# Autodesk Inventor assembly: Exploded View Z-Axis
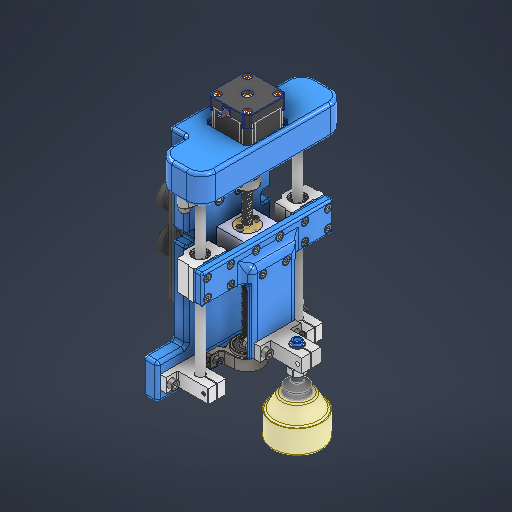
[picture p0: Inventor's stored thumbnail of the model, 512x512]
Saved by Autodesk Inventor 2027.1 (Build 311270010, 270A)
## iProperties
Created: 2026-10-04
Part Number: Exploded View Z-Axis
Document SubType Name: Assembly
Designer: Ahmed
Author: Ahmed
## iProperties of the stored document nippel.ipt
Created: 2014-03-17
Part Number: nippel
Material: Generic
Document SubType Name: Modeling
Designer: Ahmed
Density: 1 g/cm^3
Appearance: Default
Mass: 1.51643 g
Surface Area: 12.4065 cm^2
Volume: 1.51643 cm^3
Sending System: SOLIDWORKS 2012
Last Saved Date: 2014-05-13
last saved by: Oleg
Author: Ahmed
## iProperties of the stored document IPCF06-02.iam
Company: Open CASCADE
Created: 2026-10-23
Part Number: IPCF06-02
Description: Open CASCADE Model
Document SubType Name: Assembly
Designer: Ahmed
Authority: Unknown
Mass: 1.21454 g
Surface Area: 16.1477 cm^2
Volume: 1.21454 cm^3
Density: 1 g/cm^3
Sending System: Open CASCADE 7.9
Preprocessor: Open CASCADE STEP processor 7.9
Title: Open CASCADE Shape Model
Author: Author
## iProperties of the stored document Suction-ohne-nippel.ipt
Created: 2014-03-17
Part Number: Suction-ohne-nippel
Material: Generic
Document SubType Name: Modeling
Designer: Ahmed
Density: 1 g/cm^3
Appearance: Default
Mass: 1.14453 g
Surface Area: 25.0648 cm^2
Volume: 1.14453 cm^3
Sending System: SOLIDWORKS 2012
Last Saved Date: 2014-05-13
last saved by: Oleg
Author: Ahmed
## iProperties of the stored document release_ring.ipt
Created: 2026-10-23
Part Number: release_ring
Material: Generic
Document SubType Name: Modeling
Designer: Ahmed
Density: 1 g/cm^3
Appearance: Default
Mass: 0.104785 g
Surface Area: 2.06972 cm^2
Volume: 0.104785 cm^3
Author: Ahmed
## iProperties of the stored document Suction.iam
Created: 2014-03-17
Part Number: Suction
Document SubType Name: Assembly
Designer: Ahmed
Mass: 2.66095 g
Surface Area: 37.4713 cm^2
Volume: 2.66095 cm^3
Density: 1 g/cm^3
Sending System: SOLIDWORKS 2012
last saved by: Oleg
Last Saved Date: 2014-05-13
Author: Ahmed
## iProperties of the stored document body.ipt
Created: 2026-10-23
Part Number: body
Material: Generic
Document SubType Name: Modeling
Designer: Ahmed
Density: 1 g/cm^3
Appearance: Default
Mass: 1.10976 g
Surface Area: 14.0779 cm^2
Volume: 1.10976 cm^3
Author: Ahmed
## Documents named in this file (45)
- C:\Users\Ahmed\Desktop\Fall 26\MCT333 Design of Mechatronics Systems 1\Project\CAD\Exploded View Z-Axis.iam
- C:\Users\Ahmed\Desktop\Fall 26\MCT333 Design of Mechatronics Systems 1\Project\CAD\AluminumExtrusion\AluminumExtrusion\AluminiumExtrusion2020\2020extrusion_ipt\2020aluminum_extrusion_black.ipt
- C:\Users\Ahmed\Desktop\Fall 26\MCT333 Design of Mechatronics Systems 1\Project\CAD\V-Pulley.ipt
- C:\Users\Ahmed\Desktop\Fall 26\MCT333 Design of Mechatronics Systems 1\Project\CAD\VSoltGantrySetAllSizes\VSoltGantrySetAllSizes\40mm Gantry Set universal\127x88 Gantry.ipt
- C:\Users\Ahmed\Desktop\Fall 26\MCT333 Design of Mechatronics Systems 1\Project\CAD\sk8-linear-shaft-support-8mm-1.snapshot.1\SK8 Linear Shaft Support, 8mm v4\SK8 Linear Shaft Support, 8mm v4.ipt
- C:\Users\Ahmed\Desktop\Fall 26\MCT333 Design of Mechatronics Systems 1\Project\CAD\scs8uu-linear-bearing-block-8mm-shaft-1.snapshot.1\SCS8UU Block, Linear Bearing, 8mm Shaft v4\SCS8UU Block, Linear Bearing, 8mm.ipt
- C:\Users\Ahmed\Desktop\Fall 26\MCT333 Design of Mechatronics Systems 1\Project\CAD\shf10-shf8-linear-shaft-support-1.snapshot.6\SHF8\SHF8.ipt
- C:\Users\Ahmed\Desktop\Fall 26\MCT333 Design of Mechatronics Systems 1\Project\CAD\KP08 Pillow block bearing 08mm diameter\KP08 Pillow block bearing 08mm diameter.ipt
- C:\Users\Ahmed\Desktop\Fall 26\MCT333 Design of Mechatronics Systems 1\Project\CAD\nema-17-40mm-stepper-motor-1.snapshot.22\17HM15-0904S\17HM15-0904S\17HM15-0904S.ipt
- C:\Users\Ahmed\Desktop\Fall 26\MCT333 Design of Mechatronics Systems 1\Project\CAD\aluminum-flexible-shaft-coupling-5mm-x-8mm-1.snapshot.1\Flexible Shaft Coupling 5mm to 8mm\Flexible_Shaft_Coupling_5_to_8mm v7.ipt
- C:\Users\Ahmed\Desktop\Fall 26\MCT333 Design of Mechatronics Systems 1\Project\CAD\Z Bracket.ipt
- C:\Users\Ahmed\Desktop\Fall 26\MCT333 Design of Mechatronics Systems 1\Project\CAD\tr8x8-4-8mm-4-start-lead-screw-1.snapshot.6\Trapezoidal lead screw tr8x8-4\Trapezoidal lead screw tr8x8-4.ipt
- C:\Users\Ahmed\Desktop\Fall 26\MCT333 Design of Mechatronics Systems 1\Project\CAD\t8_nut_housing\t8_nut_housing.ipt
- C:\Users\Ahmed\Desktop\Fall 26\MCT333 Design of Mechatronics Systems 1\Project\CAD\shf10-shf8-linear-shaft-support-1.snapshot.6\SHF8\SHF8_MIR.ipt
- C:\Users\Ahmed\Desktop\Fall 26\MCT333 Design of Mechatronics Systems 1\Project\CAD\Linear Guide Rods.ipt
- C:\Users\Ahmed\Documents\Inventor\Content Center Files\R2027\en-US\ISO 4032(2)\ISO 4032 - M5 - ISO.ipt
- C:\Users\Ahmed\Documents\Inventor\Content Center Files\R2027\en-US\ISO 4762(2)\ISO 4762 - M5 x 16ISO.ipt
- C:\Users\Ahmed\Desktop\Fall 26\MCT333 Design of Mechatronics Systems 1\Project\CAD\Bearing Spacer.ipt
- C:\Users\Ahmed\Desktop\Fall 26\MCT333 Design of Mechatronics Systems 1\Project\CAD\Insert M5 D7 L9.5mm\Insert M5 D7 L9.5mm.ipt
- C:\Users\Ahmed\Desktop\Fall 26\MCT333 Design of Mechatronics Systems 1\Project\CAD\M4 Insert\M4 Insert.ipt
- C:\Users\Ahmed\Documents\Inventor\Content Center Files\R2027\en-US\ISO 4762(2)\ISO 4762 - M5 x 20ISO.ipt
- C:\Users\Ahmed\Documents\Inventor\Content Center Files\R2027\en-US\ISO 4762(2)\ISO 4762 - M4 x 16ISO.ipt
- C:\Users\Ahmed\Documents\Inventor\Content Center Files\R2027\en-US\ISO 4762(2)\ISO 4762 - M3 x 16ISO.ipt
- C:\Users\Ahmed\Desktop\Fall 26\MCT333 Design of Mechatronics Systems 1\Project\CAD\Linear Bearing Spacer.ipt
- C:\Users\Ahmed\Desktop\Fall 26\MCT333 Design of Mechatronics Systems 1\Project\CAD\T8 nut\T8 nut.ipt
- C:\Users\Ahmed\Documents\Inventor\Content Center Files\R2027\en-US\ISO 4762(2)\ISO 4762 - M3 x 12ISO.ipt
- C:\Users\Ahmed\Desktop\Fall 26\MCT333 Design of Mechatronics Systems 1\Project\CAD\NO-NC Bump Switch\NO-NC Bump Switch.ipt
- C:\Users\Ahmed\Desktop\Fall 26\MCT333 Design of Mechatronics Systems 1\Project\CAD\Limit Switch Spacer.ipt
- C:\Users\Ahmed\Desktop\Fall 26\MCT333 Design of Mechatronics Systems 1\Project\CAD\SK12 SHAFT HOLDER\SK12 SHAFT HOLDER.ipt
- C:\Users\Ahmed\Desktop\Fall 26\MCT333 Design of Mechatronics Systems 1\Project\CAD\Suction Cup Fixation.ipt
- **C:\Users\Ahmed\Desktop\Fall 26\MCT333 Design of Mechatronics Systems 1\Project\CAD\Exploded View Z-Axis.iam*LocalDocs*xAaaaqrcaAaaaaaaaAaaaavx32f*Suction.iam
- C:\Users\Ahmed\Documents\Inventor\Content Center Files\R2027\en-US\ISO 4762(2)\ISO 4762 - M4 x 12ISO.ipt
- C:\Users\Ahmed\Documents\Inventor\Content Center Files\R2027\en-US\ISO 4762(2)\ISO 4762 - M4 x 8ISO.ipt
- C:\Users\Ahmed\Documents\Inventor\Content Center Files\R2027\en-US\ISO 4762(2)\ISO 4762 - M2 x 12ISO.ipt
- C:\Users\Ahmed\Desktop\Fall 26\MCT333 Design of Mechatronics Systems 1\Project\CAD\Product Base.ipt
- **C:\Users\Ahmed\Desktop\Fall 26\MCT333 Design of Mechatronics Systems 1\Project\CAD\Exploded View Z-Axis.iam*LocalDocs*xAaaaa4daAaaaaaaaAaaaqi4fEb*IPCF06-02.iam
- C:\Users\Ahmed\Documents\Inventor\Content Center Files\R2027\en-US\ANSI B18.22 M\ANSI B18.22M - 5 N.ipt
- **C:\Users\Ahmed\Desktop\Fall 26\MCT333 Design of Mechatronics Systems 1\Project\CAD\Exploded View Z-Axis.iam*LocalDocs*xAaaaqcaaAaaaaaaaAaaaartaHg*nippel.ipt
- **C:\Users\Ahmed\Desktop\Fall 26\MCT333 Design of Mechatronics Systems 1\Project\CAD\Exploded View Z-Axis.iam*LocalDocs*xAaaaqzaaAaaaaaaaAaaaqmsjBh*body.ipt
- **C:\Users\Ahmed\Desktop\Fall 26\MCT333 Design of Mechatronics Systems 1\Project\CAD\Exploded View Z-Axis.iam*LocalDocs*xAaaaqibaAaaaaaaaAaaaq5znNd*release_ring.ipt
- **C:\Users\Ahmed\Desktop\Fall 26\MCT333 Design of Mechatronics Systems 1\Project\CAD\Exploded View Z-Axis.iam*LocalDocs*xAaaaqocaAaaaaaaaAaaaahhiSh*Suction-ohne-nippel.ipt
- C:\Users\Ahmed\Desktop\Fall 26\MCT333 Design of Mechatronics Systems 1\Project\CAD\Suction.SLDASM
- C:\Users\Ahmed\Desktop\Fall 26\MCT333 Design of Mechatronics Systems 1\Project\CAD\nippel.SLDPRT
- C:\Users\Ahmed\Desktop\Fall 26\MCT333 Design of Mechatronics Systems 1\Project\CAD\Suction-ohne-nippel.SLDPRT
- C:\Users\Ahmed\Desktop\Fall 26\MCT333 Design of Mechatronics Systems 1\Project\CAD\IPCF06-02.step
## Components (94 placed, 36 different names)
1. 2020aluminum_extrusion_black:1 — Tangent:9, Tangent:10, Tangent:11, Tangent:12
2. 127x88 Gantry:1 — Insert:2, Insert:4, Mate:2, Mate:3, Mate:4, Insert:27, Insert:28, Mate:89, Mate:93, Mate:94, Mate:95, Mate:97, Mate:98, Mate:99, Mate:100
3. V-Pulley:1 — Insert:2
4. V-Pulley:2 — Insert:4
5. V-Pulley:3 — Insert:28, Tangent:11, Tangent:12
6. V-Pulley:4 — Insert:27, Tangent:9, Tangent:10
7. SK8 Linear Shaft Support, 8mm v4:1 — Mate:18, Mate:29, Mate:41, Mate:42, Insert:9, Insert:10
8. SCS8UU Block, Linear Bearing, 8mm:1 — Mate:34, Angle:5, Flush:5, Mate:78
9. SHF8:1 — Mate:19, Mate:20, Mate:21, Mate:22, Insert:5, Insert:6
10. KP08 Pillow block bearing 08mm diameter:1 — Mate:47, Mate:48, Mate:49, Insert:13, Insert:14
11. 17HM15-0904S:1 — Mate:7, Mate:8, Mate:116, Mate:117
12. Flexible_Shaft_Coupling_5_to_8mm v7:1 — Mate:8, Mate:10, Mate:12, Mate:33, Mate:63, Tangent:13
13. Z Bracket:1 — Mate:2, Mate:3, Mate:4, Mate:7, Mate:10, Angle:1, Mate:18, Mate:19, Mate:20, Mate:21, Mate:22, Mate:26, Mate:27, Mate:28, Mate:30, Mate:32, Angle:6, Mate:38, Angle:7, Mate:41, Mate:42, Mate:43, Mate:44, Mate:45, Mate:47, Mate:48, Mate:49, Mate:50, Mate:51, Mate:52, Mate:53, Flush:7, Mate:54, Flush:8, Mate:55, Flush:9, Mate:56, Flush:10, Mate:57, Mate:58, Mate:59, Mate:60, Flush:11, Flush:12, Flush:13, Flush:14, Mate:61, Mate:62, Flush:15, Flush:16, Insert:15, Insert:16, Insert:17, Insert:18, Insert:23, Insert:24, Insert:25, Insert:26, Insert:29, Insert:30, Insert:31, Insert:32, Flush:17, Mate:104, Mate:105, Mate:106, Mate:116, Mate:117, Mate:138, Mate:139
14. Trapezoidal lead screw tr8x8-4:1 — Mate:12, Mate:13, Mate:33
15. t8_nut_housing:1 — Mate:13, Angle:1, Angle:4, Angle:5, Flush:5, Flush:6, Mate:63, Mate:81, Mate:82, Mate:83, Mate:107, Mate:109
16. SHF8_MIR:1 — Mate:26, Mate:27, Mate:28, Insert:7, Insert:8
17. Linear Guide Rods:1 — Mate:32, Mate:34, Mate:36, Mate:46
18. Linear Guide Rods:2 — Mate:29, Mate:30, Mate:35
19. SCS8UU Block, Linear Bearing, 8mm:2 — Mate:35, Angle:4, Flush:6, Mate:75, Mate:76
20. SK8 Linear Shaft Support, 8mm v4:2 — Mate:43, Mate:44, Mate:45, Mate:46, Insert:11, Insert:12
21. Bearing Spacer:1 — Mate:50, Mate:51, Mate:52
22. Insert M5 D7 L9.5mm:1 — Mate:53, Flush:7
23. Insert M5 D7 L9.5mm:2 — Mate:54, Flush:8
24. Insert M5 D7 L9.5mm:3 — Mate:55, Flush:9
25. Insert M5 D7 L9.5mm:4 — Mate:56, Flush:10
26. Insert M5 D7 L9.5mm:5 — Mate:58, Flush:13
27. Insert M5 D7 L9.5mm:6 — Mate:57, Flush:14
28. Insert M5 D7 L9.5mm:7 — Mate:59, Flush:11
29. Insert M5 D7 L9.5mm:8 — Mate:60, Flush:12
30. M4 Insert:1 — Mate:61, Flush:16
31. M4 Insert:2 — Mate:62, Flush:15
32. ISO 4762 M5 x 20:1 — Insert:5
33. ISO 4762 M5 x 20:2 — Insert:6
34. ISO 4762 M5 x 20:3 — Insert:7
35. ISO 4762 M5 x 20:4 — Insert:8
36. ISO 4762 M5 x 16:1 — Insert:9
37. ISO 4762 M5 x 16:2 — Insert:10
38. ISO 4762 M5 x 16:3 — Insert:12
39. ISO 4762 M5 x 16:4 — Insert:11
40. ISO 4762 M4 x 16:1 — Insert:13
41. ISO 4762 M4 x 16:2 — Insert:14
42. ISO 4762 M5 x 20:6 — Insert:16, Mate:90
43. ISO 4762 M5 x 20:5 — Insert:15, Mate:88
44. ISO 4762 M5 x 20:8 — Insert:18, Mate:91
45. ISO 4762 M5 x 20:7 — Insert:17, Mate:92
46. ISO 4032 M5:9 — Mate:92, Mate:93
47. ISO 4032 M5:8 — Mate:91, Mate:94
48. ISO 4032 M5:7 — Mate:90, Mate:95
49. ISO 4032 M5:6 — Mate:88, Mate:89
50. ISO 4762 M3 x 16:1 — Insert:23
51. ISO 4762 M3 x 16:2 — Insert:24
52. ISO 4762 M3 x 16:3 — Insert:25
53. ISO 4762 M3 x 16:4 — Insert:26
54. Linear Bearing Spacer:1 — Mate:78, Mate:148, Mate:149
55. Linear Bearing Spacer:2 — Mate:75, Mate:76, Mate:108
56. T8 nut:1 — Mate:81, Mate:82, Mate:83, Mate:84, Mate:85, Mate:86, Mate:87
57. ISO 4762 M3 x 12:1 — Mate:84, Mate:87
58. ISO 4762 M3 x 12:2 — Mate:85, Mate:86
59. ISO 4032 M5:5 — Mate:96, Mate:97
60. ISO 4762 M5 x 20:9 — Insert:29, Mate:96
61. ISO 4762 M5 x 20:10 — Insert:31, Mate:102
62. ISO 4762 M5 x 20:11 — Insert:30, Mate:103
63. ISO 4762 M5 x 20:12 — Insert:32, Mate:101
64. ISO 4032 M5:10 — Mate:100, Mate:103
65. ISO 4032 M5:11 — Mate:99, Mate:101
66. ISO 4032 M5:12 — Mate:98, Mate:102
67. NO-NC Bump Switch:1 — Tangent:13, Flush:17, Mate:115, Mate:140, Mate:141, Mate:142, Mate:143
68. Limit Switch Spacer:1 — Mate:104, Mate:105, Mate:106, Mate:115
69. SK12 SHAFT HOLDER:1 — Mate:110, Mate:111, Mate:112, Mate:113, Mate:114, Mate:134, Mate:135, Mate:136, Mate:137, Mate:146
70. Suction Cup Fixation:1 — Mate:107, Mate:108, Mate:109, Mate:110, Mate:111, Mate:112, Mate:118, Mate:119, Mate:120, Mate:121, Mate:122, Mate:123, Mate:124, Mate:125, Mate:126, Mate:127, Mate:128, Mate:129, Mate:130, Mate:131, Mate:132, Mate:133, Mate:150, Mate:151, Mate:152, Mate:153, Mate:154, Mate:155, Mate:156, Mate:157, Insert:33, Insert:34
71. Suction:1 [sub-assembly] — Mate:113, Mate:114, Mate:144, Mate:145, Mate:147
72. ISO 4762 M4 x 12:2 — Mate:118, Mate:120
73. ISO 4762 M4 x 12:1 — Mate:119, Mate:121
74. ISO 4762 M4 x 12:3 — Mate:123, Mate:124, Mate:149
75. ISO 4762 M4 x 12:4 — Mate:122, Mate:125, Mate:148
76. ISO 4762 M4 x 12:5 — Mate:151, Mate:155
77. ISO 4762 M4 x 8:1 — Mate:126, Mate:127
78. ISO 4762 M4 x 8:2 — Mate:128, Mate:129
79. ISO 4762 M4 x 16:3 — Mate:130, Mate:133
80. ISO 4762 M4 x 16:4 — Mate:131, Mate:132
81. ISO 4762 M5 x 20:14 — Mate:134, Mate:135, Mate:158
82. ISO 4762 M5 x 20:13 — Mate:136, Mate:137, Mate:160
83. ISO 4762 M3 x 16:5 — Mate:138, Mate:139
84. ISO 4762 M2 x 12:1 — Mate:140, Mate:142
85. ISO 4762 M2 x 12:2 — Mate:141, Mate:143
86. Product Base:1 — Mate:144, Mate:145
87. IPCF06-02:1 [sub-assembly] — Mate:146, Mate:147
88. ISO 4762 M4 x 12:6 — Mate:150, Mate:154
89. ISO 4762 M4 x 12:7 — Mate:152, Mate:157
90. ISO 4762 M4 x 12:8 — Mate:153, Mate:156
91. ISO 4032 M5:13 — Mate:158, Mate:161
92. ISO 4032 M5:14 — Mate:160, Mate:162
93. Plain Washer (Metric) 5 N:1 — Insert:33, Mate:161
94. Plain Washer (Metric) 5 N:2 — Insert:34, Mate:162
## Relationships (184: Mate 133, Insert 28, Flush 13, Angle 5, Tangent 5)
- Insert:2: 127x88 Gantry:1 ↔ V-Pulley:1
- Insert:4: 127x88 Gantry:1 ↔ V-Pulley:2
- Mate:2: 127x88 Gantry:1 ↔ Z Bracket:1
- Mate:3: 127x88 Gantry:1 ↔ Z Bracket:1
- Mate:4: 127x88 Gantry:1 ↔ Z Bracket:1
- Mate:7: 17HM15-0904S:1 ↔ Z Bracket:1
- Mate:8: 17HM15-0904S:1 ↔ Flexible_Shaft_Coupling_5_to_8mm v7:1
- Mate:10: Flexible_Shaft_Coupling_5_to_8mm v7:1 ↔ Z Bracket:1
- Mate:12: Flexible_Shaft_Coupling_5_to_8mm v7:1 ↔ Trapezoidal lead screw tr8x8-4:1
- Mate:13: Trapezoidal lead screw tr8x8-4:1 ↔ t8_nut_housing:1
- Angle:1 (0 deg): Z Bracket:1 ↔ t8_nut_housing:1
- Mate:18: SK8 Linear Shaft Support, 8mm v4:1 ↔ Z Bracket:1
- Mate:19: SHF8:1 ↔ Z Bracket:1
- Mate:20: SHF8:1 ↔ Z Bracket:1
- Mate:21: SHF8:1 ↔ Z Bracket:1
- Mate:22: SHF8:1 ↔ Z Bracket:1
- Mate:26: Z Bracket:1 ↔ SHF8_MIR:1
- Mate:27: Z Bracket:1 ↔ SHF8_MIR:1
- Mate:28: Z Bracket:1 ↔ SHF8_MIR:1
- Mate:29: SK8 Linear Shaft Support, 8mm v4:1 ↔ Linear Guide Rods:2
- Mate:30: Z Bracket:1 ↔ Linear Guide Rods:2
- Mate:32: Z Bracket:1 ↔ Linear Guide Rods:1
- Mate:33: Flexible_Shaft_Coupling_5_to_8mm v7:1 ↔ Trapezoidal lead screw tr8x8-4:1
- Mate:34: SCS8UU Block, Linear Bearing, 8mm:1 ↔ Linear Guide Rods:1
- Mate:35: Linear Guide Rods:2 ↔ SCS8UU Block, Linear Bearing, 8mm:2
- Angle:4 (0 deg): t8_nut_housing:1 ↔ SCS8UU Block, Linear Bearing, 8mm:2
- Angle:5 (0 deg): SCS8UU Block, Linear Bearing, 8mm:1 ↔ t8_nut_housing:1
- Mate:36: Linear Guide Rods:1
- Mate:37
- Angle:6 (90 deg): Z Bracket:1
- Mate:38: Z Bracket:1
- Mate:39
- Angle:7 (90 deg): Z Bracket:1
- Flush:5: SCS8UU Block, Linear Bearing, 8mm:1 ↔ t8_nut_housing:1
- Flush:6: t8_nut_housing:1 ↔ SCS8UU Block, Linear Bearing, 8mm:2
- Mate:41: SK8 Linear Shaft Support, 8mm v4:1 ↔ Z Bracket:1
- Mate:42: SK8 Linear Shaft Support, 8mm v4:1 ↔ Z Bracket:1
- Mate:43: Z Bracket:1 ↔ SK8 Linear Shaft Support, 8mm v4:2
- Mate:44: Z Bracket:1 ↔ SK8 Linear Shaft Support, 8mm v4:2
- Mate:45: Z Bracket:1 ↔ SK8 Linear Shaft Support, 8mm v4:2
- Mate:46: Linear Guide Rods:1 ↔ SK8 Linear Shaft Support, 8mm v4:2
- Mate:47: KP08 Pillow block bearing 08mm diameter:1 ↔ Z Bracket:1
- Mate:48: KP08 Pillow block bearing 08mm diameter:1 ↔ Z Bracket:1
- Mate:49: KP08 Pillow block bearing 08mm diameter:1 ↔ Z Bracket:1
- Mate:50: Z Bracket:1 ↔ Bearing Spacer:1
- Mate:51: Z Bracket:1 ↔ Bearing Spacer:1
- Mate:52: Z Bracket:1 ↔ Bearing Spacer:1
- Mate:53: Z Bracket:1 ↔ Insert M5 D7 L9.5mm:1
- Flush:7: Z Bracket:1 ↔ Insert M5 D7 L9.5mm:1
- Mate:54: Z Bracket:1 ↔ Insert M5 D7 L9.5mm:2
- Flush:8: Z Bracket:1 ↔ Insert M5 D7 L9.5mm:2
- Mate:55: Z Bracket:1 ↔ Insert M5 D7 L9.5mm:3
- Flush:9: Z Bracket:1 ↔ Insert M5 D7 L9.5mm:3
- Mate:56: Z Bracket:1 ↔ Insert M5 D7 L9.5mm:4
- Flush:10: Z Bracket:1 ↔ Insert M5 D7 L9.5mm:4
- Mate:57: Z Bracket:1 ↔ Insert M5 D7 L9.5mm:6
- Mate:58: Z Bracket:1 ↔ Insert M5 D7 L9.5mm:5
- Mate:59: Z Bracket:1 ↔ Insert M5 D7 L9.5mm:7
- Mate:60: Z Bracket:1 ↔ Insert M5 D7 L9.5mm:8
- Flush:11: Z Bracket:1 ↔ Insert M5 D7 L9.5mm:7
- Flush:12: Z Bracket:1 ↔ Insert M5 D7 L9.5mm:8
- Flush:13: Z Bracket:1 ↔ Insert M5 D7 L9.5mm:5
- Flush:14: Z Bracket:1 ↔ Insert M5 D7 L9.5mm:6
- Mate:61: Z Bracket:1 ↔ M4 Insert:1
- Mate:62: Z Bracket:1 ↔ M4 Insert:2
- Flush:15: Z Bracket:1 ↔ M4 Insert:2
- Flush:16: Z Bracket:1 ↔ M4 Insert:1
- Insert:5: SHF8:1 ↔ ISO 4762 M5 x 20:1
- Insert:6: SHF8:1 ↔ ISO 4762 M5 x 20:2
- Insert:7: SHF8_MIR:1 ↔ ISO 4762 M5 x 20:3
- Insert:8: SHF8_MIR:1 ↔ ISO 4762 M5 x 20:4
- Insert:9: SK8 Linear Shaft Support, 8mm v4:1 ↔ ISO 4762 M5 x 16:1
- Insert:10: SK8 Linear Shaft Support, 8mm v4:1 ↔ ISO 4762 M5 x 16:2
- Insert:11: SK8 Linear Shaft Support, 8mm v4:2 ↔ ISO 4762 M5 x 16:4
- Insert:12: SK8 Linear Shaft Support, 8mm v4:2 ↔ ISO 4762 M5 x 16:3
- Insert:13: KP08 Pillow block bearing 08mm diameter:1 ↔ ISO 4762 M4 x 16:1
- Insert:14: KP08 Pillow block bearing 08mm diameter:1 ↔ ISO 4762 M4 x 16:2
- Insert:15: Z Bracket:1 ↔ ISO 4762 M5 x 20:5
- Insert:16: Z Bracket:1 ↔ ISO 4762 M5 x 20:6
- Insert:17: Z Bracket:1 ↔ ISO 4762 M5 x 20:7
- Insert:18: Z Bracket:1 ↔ ISO 4762 M5 x 20:8
- Insert:23: Z Bracket:1 ↔ ISO 4762 M3 x 16:1
- Insert:24: Z Bracket:1 ↔ ISO 4762 M3 x 16:2
- Insert:25: Z Bracket:1 ↔ ISO 4762 M3 x 16:3
- Insert:26: Z Bracket:1 ↔ ISO 4762 M3 x 16:4
- Mate:63: Flexible_Shaft_Coupling_5_to_8mm v7:1 ↔ t8_nut_housing:1
- Mate:75: SCS8UU Block, Linear Bearing, 8mm:2 ↔ Linear Bearing Spacer:2
- Mate:76: SCS8UU Block, Linear Bearing, 8mm:2 ↔ Linear Bearing Spacer:2
- Mate:78: SCS8UU Block, Linear Bearing, 8mm:1 ↔ Linear Bearing Spacer:1
- Insert:27: 127x88 Gantry:1 ↔ V-Pulley:4
- Insert:28: 127x88 Gantry:1 ↔ V-Pulley:3
- Tangent:9: 2020aluminum_extrusion_black:1 ↔ V-Pulley:4
- Tangent:10: 2020aluminum_extrusion_black:1 ↔ V-Pulley:4
- Tangent:11: 2020aluminum_extrusion_black:1 ↔ V-Pulley:3
- Tangent:12: 2020aluminum_extrusion_black:1 ↔ V-Pulley:3
- Mate:81: t8_nut_housing:1 ↔ T8 nut:1
- Mate:82: t8_nut_housing:1 ↔ T8 nut:1
- Mate:83: t8_nut_housing:1 ↔ T8 nut:1
- Mate:84: T8 nut:1 ↔ ISO 4762 M3 x 12:1
- Mate:85: T8 nut:1 ↔ ISO 4762 M3 x 12:2
- Mate:86: T8 nut:1 ↔ ISO 4762 M3 x 12:2
- Mate:87: T8 nut:1 ↔ ISO 4762 M3 x 12:1
- Mate:88: ISO 4762 M5 x 20:5 ↔ ISO 4032 M5:6
- Mate:89: 127x88 Gantry:1 ↔ ISO 4032 M5:6
- Mate:90: ISO 4762 M5 x 20:6 ↔ ISO 4032 M5:7
- Mate:91: ISO 4762 M5 x 20:8 ↔ ISO 4032 M5:8
- Mate:92: ISO 4762 M5 x 20:7 ↔ ISO 4032 M5:9
- Mate:93: 127x88 Gantry:1 ↔ ISO 4032 M5:9
- Mate:94: 127x88 Gantry:1 ↔ ISO 4032 M5:8
- Mate:95: 127x88 Gantry:1 ↔ ISO 4032 M5:7
- Insert:29: Z Bracket:1 ↔ ISO 4762 M5 x 20:9
- Insert:30: Z Bracket:1 ↔ ISO 4762 M5 x 20:11
- Insert:31: Z Bracket:1 ↔ ISO 4762 M5 x 20:10
- Insert:32: Z Bracket:1 ↔ ISO 4762 M5 x 20:12
- Mate:96: ISO 4032 M5:5 ↔ ISO 4762 M5 x 20:9
- Mate:97: 127x88 Gantry:1 ↔ ISO 4032 M5:5
- Mate:98: 127x88 Gantry:1 ↔ ISO 4032 M5:12
- Mate:99: 127x88 Gantry:1 ↔ ISO 4032 M5:11
- Mate:100: 127x88 Gantry:1 ↔ ISO 4032 M5:10
- Mate:101: ISO 4762 M5 x 20:12 ↔ ISO 4032 M5:11
- Mate:102: ISO 4762 M5 x 20:10 ↔ ISO 4032 M5:12
- Mate:103: ISO 4762 M5 x 20:11 ↔ ISO 4032 M5:10
- Tangent:13 (-10 mm): Flexible_Shaft_Coupling_5_to_8mm v7:1 ↔ NO-NC Bump Switch:1
- Flush:17 (9 mm): Z Bracket:1 ↔ NO-NC Bump Switch:1
- Mate:104: Z Bracket:1 ↔ Limit Switch Spacer:1
- Mate:105: Z Bracket:1 ↔ Limit Switch Spacer:1
- Mate:106: Z Bracket:1 ↔ Limit Switch Spacer:1
- Mate:107: t8_nut_housing:1 ↔ Suction Cup Fixation:1
- Mate:108: Linear Bearing Spacer:2 ↔ Suction Cup Fixation:1
- Mate:109: t8_nut_housing:1 ↔ Suction Cup Fixation:1
- Mate:110: SK12 SHAFT HOLDER:1 ↔ Suction Cup Fixation:1
- Mate:111: SK12 SHAFT HOLDER:1 ↔ Suction Cup Fixation:1
- Mate:112: SK12 SHAFT HOLDER:1 ↔ Suction Cup Fixation:1
- Mate:113: SK12 SHAFT HOLDER:1 ↔ Suction:1
- Mate:114 (4 mm): SK12 SHAFT HOLDER:1 ↔ Suction:1
- Mate:115: NO-NC Bump Switch:1 ↔ Limit Switch Spacer:1
- Mate:116: 17HM15-0904S:1 ↔ Z Bracket:1
- Mate:117: 17HM15-0904S:1 ↔ Z Bracket:1
- Mate:118: Suction Cup Fixation:1 ↔ ISO 4762 M4 x 12:2
- Mate:119: Suction Cup Fixation:1 ↔ ISO 4762 M4 x 12:1
- Mate:120: Suction Cup Fixation:1 ↔ ISO 4762 M4 x 12:2
- Mate:121: Suction Cup Fixation:1 ↔ ISO 4762 M4 x 12:1
- Mate:122: Suction Cup Fixation:1 ↔ ISO 4762 M4 x 12:4
- Mate:123: Suction Cup Fixation:1 ↔ ISO 4762 M4 x 12:3
- Mate:124: Suction Cup Fixation:1 ↔ ISO 4762 M4 x 12:3
- Mate:125: Suction Cup Fixation:1 ↔ ISO 4762 M4 x 12:4
- Mate:126: Suction Cup Fixation:1 ↔ ISO 4762 M4 x 8:1
- Mate:127: Suction Cup Fixation:1 ↔ ISO 4762 M4 x 8:1
- Mate:128: Suction Cup Fixation:1 ↔ ISO 4762 M4 x 8:2
- Mate:129: Suction Cup Fixation:1 ↔ ISO 4762 M4 x 8:2
- Mate:130: Suction Cup Fixation:1 ↔ ISO 4762 M4 x 16:3
- Mate:131: Suction Cup Fixation:1 ↔ ISO 4762 M4 x 16:4
- Mate:132: Suction Cup Fixation:1 ↔ ISO 4762 M4 x 16:4
- Mate:133: Suction Cup Fixation:1 ↔ ISO 4762 M4 x 16:3
- Mate:134: SK12 SHAFT HOLDER:1 ↔ ISO 4762 M5 x 20:14
- Mate:135: SK12 SHAFT HOLDER:1 ↔ ISO 4762 M5 x 20:14
- Mate:136: SK12 SHAFT HOLDER:1 ↔ ISO 4762 M5 x 20:13
- Mate:137: SK12 SHAFT HOLDER:1 ↔ ISO 4762 M5 x 20:13
- Mate:138: Z Bracket:1 ↔ ISO 4762 M3 x 16:5
- Mate:139: Z Bracket:1 ↔ ISO 4762 M3 x 16:5
- Mate:140: NO-NC Bump Switch:1 ↔ ISO 4762 M2 x 12:1
- Mate:141: NO-NC Bump Switch:1 ↔ ISO 4762 M2 x 12:2
- Mate:142: NO-NC Bump Switch:1 ↔ ISO 4762 M2 x 12:1
- Mate:143: NO-NC Bump Switch:1 ↔ ISO 4762 M2 x 12:2
- Mate:144: Suction:1 ↔ Product Base:1
- Mate:145: Suction:1 ↔ Product Base:1
- Mate:146: SK12 SHAFT HOLDER:1 ↔ IPCF06-02:1
- Mate:147: Suction:1 ↔ IPCF06-02:1
- Mate:148: Linear Bearing Spacer:1 ↔ ISO 4762 M4 x 12:4
- Mate:149: Linear Bearing Spacer:1 ↔ ISO 4762 M4 x 12:3
- Mate:150: Suction Cup Fixation:1 ↔ ISO 4762 M4 x 12:6
- Mate:151: Suction Cup Fixation:1 ↔ ISO 4762 M4 x 12:5
- Mate:152: Suction Cup Fixation:1 ↔ ISO 4762 M4 x 12:7
- Mate:153: Suction Cup Fixation:1 ↔ ISO 4762 M4 x 12:8
- Mate:154: Suction Cup Fixation:1 ↔ ISO 4762 M4 x 12:6
- Mate:155: Suction Cup Fixation:1 ↔ ISO 4762 M4 x 12:5
- Mate:156: Suction Cup Fixation:1 ↔ ISO 4762 M4 x 12:8
- Mate:157: Suction Cup Fixation:1 ↔ ISO 4762 M4 x 12:7
- Mate:158: ISO 4762 M5 x 20:14 ↔ ISO 4032 M5:13
- Mate:160: ISO 4762 M5 x 20:13 ↔ ISO 4032 M5:14
- Insert:33: Suction Cup Fixation:1 ↔ Plain Washer (Metric) 5 N:1
- Insert:34: Suction Cup Fixation:1 ↔ Plain Washer (Metric) 5 N:2
- Mate:161: ISO 4032 M5:13 ↔ Plain Washer (Metric) 5 N:1
- Mate:162: ISO 4032 M5:14 ↔ Plain Washer (Metric) 5 N:2
## Named parameters: M3_Insert_Nut_Hole = 4 mm, M4_Insert_Nut_Hole = 1 mm, M5_Insert_Nut_Hole = 5.7 mm
